# Autodesk Inventor assembly: LegUnit_single
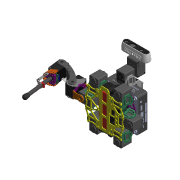
[picture p0: Inventor's stored thumbnail of the model, 180x180]
Saved by Autodesk Inventor 2018.3 (Build 223284000, 284)
## iProperties
Created: 2019-02-19
Part Number: LegUnit_single
Material: 一般
Document SubType Name: Assembly
Designer: y6tada
Author: y6tada
## Documents named in this file (7)
- D:\2019.3 - HaptHexa\Hardware\Mech\Inventor\LegUnit_single.iam
- D:\2019.3 - HaptHexa\Hardware\Mech\Inventor\Thorax\_Thorax.iam
- D:\2019.3 - HaptHexa\Hardware\Mech\Inventor\Coxa\_Coxa.iam
- D:\2019.3 - HaptHexa\Hardware\Mech\Inventor\Tibia\_Tibia.iam
- D:\2019.3 - HaptHexa\Hardware\Mech\Inventor\Femur\_Femur.iam
- D:\2019.3 - HaptHexa\Hardware\Mech\Inventor\Computer\_Computer.iam
- D:\2019.3 - HaptHexa\Hardware\Mech\Inventor\Computer\Intel Realsense D435\D435_ipt.ipt
## Components (6 placed, 6 different names)
1. _Thorax:1 [sub-assembly] — 角度:4, メイト:7, メイト:8, メイト:13, メイト:14
2. _Coxa:1 [sub-assembly] — 角度:4, メイト:7, メイト:8, メイト:9, メイト:10, 角度:5
3. _Tibia:1 [sub-assembly] — メイト:11, メイト:12, 角度:6
4. _Femur:1 [sub-assembly] — メイト:9, メイト:10, メイト:11, メイト:12, 角度:5, 角度:6
5. _Computer:1 [sub-assembly] — フラッシュ:1, メイト:13, メイト:14, フラッシュ:2
6. D435_ipt:1 — フラッシュ:2
## Relationships (13: Mate 8, Angle 3, Flush 2)
- 角度:4 [Angle] (0 deg): _Thorax:1 ↔ _Coxa:1
- メイト:7 [Mate]: _Thorax:1 ↔ _Coxa:1
- メイト:8 [Mate]: _Thorax:1 ↔ _Coxa:1
- メイト:9 [Mate]: _Coxa:1 ↔ _Femur:1
- メイト:10 [Mate]: _Coxa:1 ↔ _Femur:1
- メイト:11 [Mate]: _Tibia:1 ↔ _Femur:1
- メイト:12 [Mate]: _Tibia:1 ↔ _Femur:1
- 角度:5 [Angle] (0 deg): _Coxa:1 ↔ _Femur:1
- 角度:6 [Angle] (0 deg): _Tibia:1 ↔ _Femur:1
- フラッシュ:1 [Flush]: _Computer:1
- メイト:13 [Mate]: _Thorax:1 ↔ _Computer:1
- メイト:14 [Mate]: _Thorax:1 ↔ _Computer:1
- フラッシュ:2 [Flush]: _Computer:1 ↔ D435_ipt:1
